# Autodesk Inventor assembly: Antrieb_links
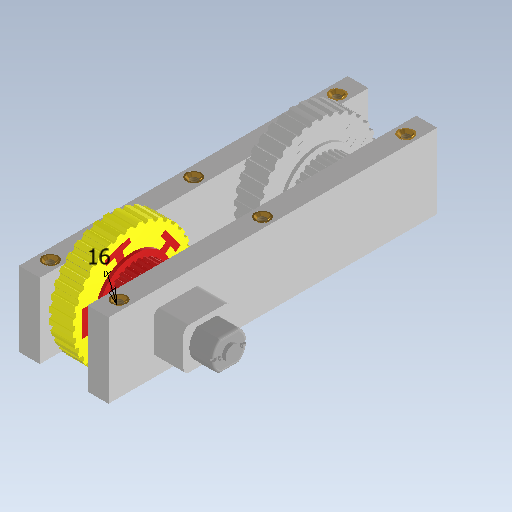
[picture p0: Inventor's stored thumbnail of the model, 512x512]
Saved by Autodesk Inventor 2026.4 (Build 304435030, 435C)
## iProperties
Created: 2026-11-13
Part Number: Antrieb_links
Document SubType Name: Assembly
Designer: weira
Mass: 134.432 g
Surface Area: 497.364 cm^2
Volume: 95.1111 cm^3
Density: 1.41342 g/cm^3
Author: weira
## Documents named in this file (8)
- C:\Users\weira\OneDrive\Desktop\Battlebot Projekt\Battle-Bot-Project\Inventor\Fahrseite\Antrieb_links.iam
- C:\Users\weira\OneDrive\Desktop\Battlebot Projekt\Battle-Bot-Project\Inventor\Fahrseite\Rad mit Riehmenscheibe.ipt
- C:\Users\weira\OneDrive\Desktop\Battlebot Projekt\Battle-Bot-Project\Inventor\689-ZZ-Kugellager.ipt
- C:\Users\weira\OneDrive\Desktop\Battlebot Projekt\Battle-Bot-Project\Inventor\Kaufteile\N30_Gear_Motor\N30_Gear_Motor.ipt
- C:\Users\weira\OneDrive\Desktop\Battlebot Projekt\Battle-Bot-Project\Inventor\Fahrseite\Seitenteil_innen.ipt
- C:\Users\weira\OneDrive\Desktop\Battlebot Projekt\Battle-Bot-Project\Inventor\Fahrseite\Seitenteil_außen.ipt
- C:\Users\weira\OneDrive\Desktop\Battlebot Projekt\Battle-Bot-Project\Inventor\Fahrseite\Antriebsrad mit Riemenscheibe.ipt
- C:\Users\weira\OneDrive\Desktop\Battlebot Projekt\Battle-Bot-Project\Inventor\Fahrseite\Gewindemuffe m3x25.ipt
## Components (14 placed, 7 different names)
1. Seitenteil_außen:2 — Passend:1, Fluchtend:1, Passend:2, Fluchtend:2, Fluchtend:3, Passend:3, Passend:4, Passend:5, Passend:6, Passend:7, Passend:8, Winkel:1, Passend:18, Passend:20, Passend:21, Fluchtend:4, Fluchtend:5, Fluchtend:6
2. Seitenteil_innen:1 — Fluchtend:2, Fluchtend:3, Passend:3, Passend:12, Passend:13, Passend:14, Passend:16, Passend:17, Passend:19, Passend:22, Passend:23, Fluchtend:7, Fluchtend:8, Fluchtend:9
3. 689-ZZ-Kugellager:1 — Passend:4, Passend:7
4. 689-ZZ-Kugellager:2 — Passend:5, Passend:6, Passend:9
5. Rad mit Riehmenscheibe:1 — Passend:8, Passend:9, Winkel:1
6. N30_Gear_Motor:1 — Passend:12, Passend:13, Passend:15, Passend:24
7. Antriebsrad mit Riemenscheibe:1 — Passend:14, Passend:15, Passend:24
8. 689-ZZ-Kugellager:3 — Passend:16, Passend:17
9. Gewindemuffe m3x25:1 — Passend:23, Fluchtend:8
10. Gewindemuffe m3x25:2 — Passend:19, Fluchtend:7
11. Gewindemuffe m3x25:3 — Passend:22, Fluchtend:9
12. Gewindemuffe m3x25:4 — Passend:21, Fluchtend:4
13. Gewindemuffe m3x25:5 — Passend:20, Fluchtend:5
14. Gewindemuffe m3x25:6 — Passend:18, Fluchtend:6
## Relationships (32: Mate 22, Flush 9, Angle 1)
- Passend:1 [Mate]: Seitenteil_außen:2
- Fluchtend:1 [Flush]: Seitenteil_außen:2
- Passend:2 [Mate]: Seitenteil_außen:2
- Fluchtend:2 [Flush]: Seitenteil_außen:2 ↔ Seitenteil_innen:1
- Fluchtend:3 [Flush]: Seitenteil_außen:2 ↔ Seitenteil_innen:1
- Passend:3 [Mate] (16 mm): Seitenteil_außen:2 ↔ Seitenteil_innen:1
- Passend:4 [Mate]: Seitenteil_außen:2 ↔ 689-ZZ-Kugellager:1
- Passend:5 [Mate]: Seitenteil_außen:2 ↔ 689-ZZ-Kugellager:2
- Passend:6 [Mate]: Seitenteil_außen:2 ↔ 689-ZZ-Kugellager:2
- Passend:7 [Mate]: Seitenteil_außen:2 ↔ 689-ZZ-Kugellager:1
- Passend:8 [Mate]: Seitenteil_außen:2 ↔ Rad mit Riehmenscheibe:1
- Passend:9 [Mate]: 689-ZZ-Kugellager:2 ↔ Rad mit Riehmenscheibe:1
- Winkel:1 [Angle] (0 deg): Seitenteil_außen:2 ↔ Rad mit Riehmenscheibe:1
- Passend:12 [Mate]: Seitenteil_innen:1 ↔ N30_Gear_Motor:1
- Passend:13 [Mate]: Seitenteil_innen:1 ↔ N30_Gear_Motor:1
- Passend:14 [Mate]: Seitenteil_innen:1 ↔ Antriebsrad mit Riemenscheibe:1
- Passend:15 [Mate]: N30_Gear_Motor:1 ↔ Antriebsrad mit Riemenscheibe:1
- Passend:16 [Mate]: Seitenteil_innen:1 ↔ 689-ZZ-Kugellager:3
- Passend:17 [Mate]: Seitenteil_innen:1 ↔ 689-ZZ-Kugellager:3
- Passend:18 [Mate]: Seitenteil_außen:2 ↔ Gewindemuffe m3x25:6
- Passend:19 [Mate]: Seitenteil_innen:1 ↔ Gewindemuffe m3x25:2
- Passend:20 [Mate]: Seitenteil_außen:2 ↔ Gewindemuffe m3x25:5
- Passend:21 [Mate]: Seitenteil_außen:2 ↔ Gewindemuffe m3x25:4
- Passend:22 [Mate]: Seitenteil_innen:1 ↔ Gewindemuffe m3x25:3
- Passend:23 [Mate]: Seitenteil_innen:1 ↔ Gewindemuffe m3x25:1
- Fluchtend:4 [Flush]: Seitenteil_außen:2 ↔ Gewindemuffe m3x25:4
- Fluchtend:5 [Flush]: Seitenteil_außen:2 ↔ Gewindemuffe m3x25:5
- Fluchtend:6 [Flush]: Seitenteil_außen:2 ↔ Gewindemuffe m3x25:6
- Fluchtend:7 [Flush]: Seitenteil_innen:1 ↔ Gewindemuffe m3x25:2
- Fluchtend:8 [Flush]: Seitenteil_innen:1 ↔ Gewindemuffe m3x25:1
- Fluchtend:9 [Flush]: Seitenteil_innen:1 ↔ Gewindemuffe m3x25:3
- Passend:24 [Mate] (2 mm): N30_Gear_Motor:1 ↔ Antriebsrad mit Riemenscheibe:1
